# Autodesk Inventor assembly: BG002_bensen22_26
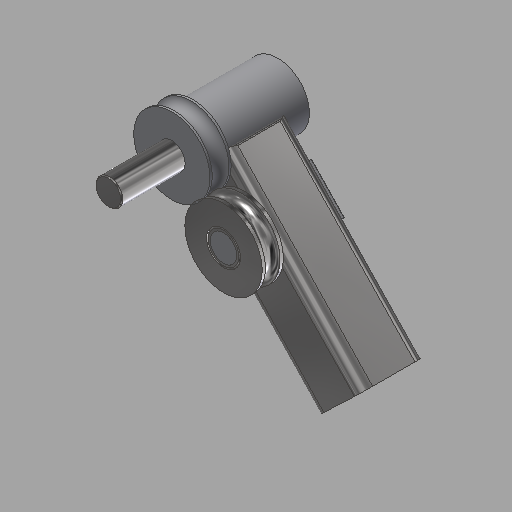
[picture p0: Inventor's stored thumbnail of the model, 512x512]
Saved by Autodesk Inventor 2025.3 (Build 293356000, 356)
## iProperties
Company: HTBLA Kaindorf
RuleStatus: InUse
Created: 2026-08-10
Part Number: BG002_bensen22_26
Project: Biegeroboter
Material: Generisch
Description: verlängerung_gesamt_v1
Document SubType Name: Assembly
Designer: bensen22
Mass: 2635.14 g
Surface Area: 1713.5 cm^2
Volume: 552.549 cm^3
Density: 4.76907 g/cm^3
AfterDocNew0: iProperties-Editor_aufrufen
Author: sebas
Keywords: 2026
## Documents named in this file (9)
- C:\Users\trist\Desktop\Schule\diplomarbeit_dateien\Mechanik\Biegekopf\Verlängerung\BG002_bensen22_26_Biegeroboter_verlängerung_gesamt_v1.iam
- C:\Users\trist\Desktop\Schule\diplomarbeit_dateien\Mechanik\Biegekopf\Verlängerung\BT007_bensen22_26_Biegeroboter_verlängerung_aufnahme_v1.ipt
- C:\Users\trist\Documents\Inventor\Content Center Files\R2025\de-DE\BS 290 SKF(30)\BS 290 SKF - SKF 6205.ipt
- C:\Users\trist\Desktop\Schule\diplomarbeit_dateien\Mechanik\Biegekopf\Verlängerung\BT008_bensen22_26_Biegeroboter_verlängerung_stab_v1.ipt
- C:\Users\trist\Desktop\Schule\diplomarbeit_dateien\Mechanik\Biegekopf\Verlängerung\BT009_bensen22_26_Biegeroboter_verlängerung_bolzen_v1.ipt
- C:\Users\trist\Desktop\Schule\diplomarbeit_dateien\Mechanik\Biegekopf\Bolzen\Bolzen\Bolzen.ipt
- C:\Users\trist\Desktop\Schule\diplomarbeit_dateien\Mechanik\Biegekopf\Hantelrolle\Hantelrolle.ipt
- C:\Users\trist\Documents\Inventor\Content Center Files\R2025\de-DE\DIN 618 - T1  HK\DIN 618 - HK2520 - 25 x 32 x 20.ipt
- C:\Users\trist\Desktop\Schule\diplomarbeit_dateien\Mechanik\Biegerolle\BT009_thutrn22_26_Biegeroboter_biegerolle_v1.ipt
## Components (8 placed, 8 different names)
1. BT007_bensen22_26_Biegeroboter_verlängerung_aufnahme_v1:1 — Passend:1, Passend:2, Passend:3, Fluchtend:1, Passend:9, Passend:16
2. BS 290 SKF 6205:1 — Passend:1, Passend:2, Fluchtend:2, Passend:8
3. BT008_bensen22_26_Biegeroboter_verlängerung_stab_v1:1 — Passend:3, Fluchtend:1, Fluchtend:2, Passend:4, Passend:5, Passend:6, Passend:18, Passend:19
4. BT009_bensen22_26_Biegeroboter_verlängerung_bolzen_v1:1 — Passend:4, Passend:5, Passend:6, Passend:13
5. Bolzen:1 — Passend:8, Passend:9, Passend:15
6. Hantelrolle:1 — Passend:17, Passend:18
7. DIN 618 - T1 HK HK2520 - 25 x 32 x 20:1 — Passend:13, Passend:17, Passend:19
8. BT009_thutrn22_26_Biegeroboter_biegerolle_v1:1 — Passend:15, Passend:16
## Relationships (16: Mate 14, Flush 2)
- Passend:1 [Mate]: BT007_bensen22_26_Biegeroboter_verlängerung_aufnahme_v1:1 ↔ BS 290 SKF 6205:1
- Passend:2 [Mate]: BT007_bensen22_26_Biegeroboter_verlängerung_aufnahme_v1:1 ↔ BS 290 SKF 6205:1
- Passend:3 [Mate]: BT007_bensen22_26_Biegeroboter_verlängerung_aufnahme_v1:1 ↔ BT008_bensen22_26_Biegeroboter_verlängerung_stab_v1:1
- Fluchtend:1 [Flush]: BT007_bensen22_26_Biegeroboter_verlängerung_aufnahme_v1:1 ↔ BT008_bensen22_26_Biegeroboter_verlängerung_stab_v1:1
- Fluchtend:2 [Flush]: BS 290 SKF 6205:1 ↔ BT008_bensen22_26_Biegeroboter_verlängerung_stab_v1:1
- Passend:4 [Mate]: BT008_bensen22_26_Biegeroboter_verlängerung_stab_v1:1 ↔ BT009_bensen22_26_Biegeroboter_verlängerung_bolzen_v1:1
- Passend:5 [Mate]: BT008_bensen22_26_Biegeroboter_verlängerung_stab_v1:1 ↔ BT009_bensen22_26_Biegeroboter_verlängerung_bolzen_v1:1
- Passend:6 [Mate]: BT008_bensen22_26_Biegeroboter_verlängerung_stab_v1:1 ↔ BT009_bensen22_26_Biegeroboter_verlängerung_bolzen_v1:1
- Passend:8 [Mate]: BS 290 SKF 6205:1 ↔ Bolzen:1
- Passend:9 [Mate]: BT007_bensen22_26_Biegeroboter_verlängerung_aufnahme_v1:1 ↔ Bolzen:1
- Passend:13 [Mate]: BT009_bensen22_26_Biegeroboter_verlängerung_bolzen_v1:1 ↔ DIN 618 - T1 HK HK2520 - 25 x 32 x 20:1
- Passend:15 [Mate]: Bolzen:1 ↔ BT009_thutrn22_26_Biegeroboter_biegerolle_v1:1
- Passend:16 [Mate]: BT007_bensen22_26_Biegeroboter_verlängerung_aufnahme_v1:1 ↔ BT009_thutrn22_26_Biegeroboter_biegerolle_v1:1
- Passend:17 [Mate]: Hantelrolle:1 ↔ DIN 618 - T1 HK HK2520 - 25 x 32 x 20:1
- Passend:18 [Mate]: BT008_bensen22_26_Biegeroboter_verlängerung_stab_v1:1 ↔ Hantelrolle:1
- Passend:19 [Mate]: BT008_bensen22_26_Biegeroboter_verlängerung_stab_v1:1 ↔ DIN 618 - T1 HK HK2520 - 25 x 32 x 20:1
